# Autodesk Inventor assembly: Huelse_2_komplett
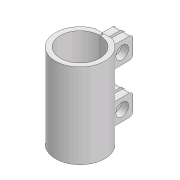
[picture p0: Inventor's stored thumbnail of the model, 180x180]
Saved by Autodesk Inventor 2020.1 (Build 241239000, 239)
## iProperties
Created: 2020-09-23
Part Number: Huelse_2_komplett
Document SubType Name: Assembly
Designer: s5chfeis
Author: s5chfeis
## Documents named in this file (3)
- Z:\Masterarbeit\CAD\CAD\Huelse_2_komplett.iam
- Z:\Masterarbeit\CAD\CAD\Hülse2.ipt
- Z:\Masterarbeit\CAD\CAD\Hülse_1.ipt
## Components (5 placed, 2 different names)
1. Hülse2:1 — Passend:1, Passend:2, Passend:3, Passend:4, Passend:5, Passend:6, Passend:7, Passend:8, Passend:9, Passend:10, Passend:11, Passend:12
2. Hülse_1:1 — Passend:1, Passend:2, Passend:3
3. Hülse_1:2 — Passend:10, Passend:11, Passend:12
4. Hülse_1:3 — Passend:7, Passend:8, Passend:9
5. Hülse_1:4 — Passend:4, Passend:5, Passend:6
## Relationships (12: Mate 12)
- Passend:1 [Mate]: Hülse2:1 ↔ Hülse_1:1
- Passend:2 [Mate]: Hülse2:1 ↔ Hülse_1:1
- Passend:3 [Mate] (55 mm): Hülse2:1 ↔ Hülse_1:1
- Passend:4 [Mate]: Hülse2:1 ↔ Hülse_1:4
- Passend:5 [Mate]: Hülse2:1 ↔ Hülse_1:4
- Passend:6 [Mate] (5 mm): Hülse2:1 ↔ Hülse_1:4
- Passend:7 [Mate]: Hülse2:1 ↔ Hülse_1:3
- Passend:8 [Mate]: Hülse2:1 ↔ Hülse_1:3
- Passend:9 [Mate] (5 mm): Hülse2:1 ↔ Hülse_1:3
- Passend:10 [Mate]: Hülse2:1 ↔ Hülse_1:2
- Passend:11 [Mate]: Hülse2:1 ↔ Hülse_1:2
- Passend:12 [Mate] (5 mm): Hülse2:1 ↔ Hülse_1:2
